# Autodesk Inventor assembly: Samenstelling_backup
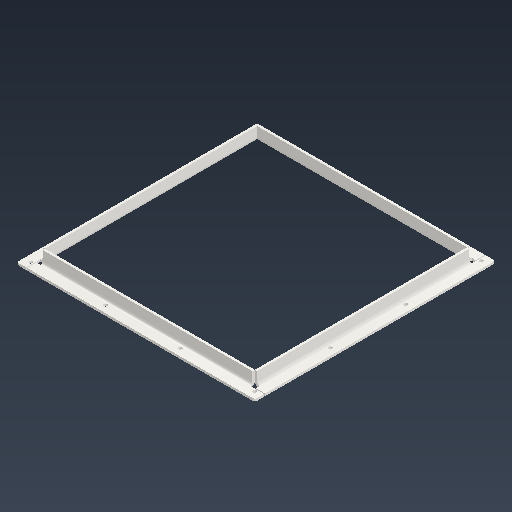
[picture p0: Inventor's stored thumbnail of the model, 512x512]
Saved by Autodesk Inventor 2025.5 (Build 295498000, 498)
## iProperties
RuleStatus: InUse
Created: 2026-10-08
Part Number: Samenstelling_backup
Material: Steel
Document SubType Name: Assembly
Designer: Jasper Kusters
Mass: 3773.45 g
Surface Area: 2154.34 cm^2
Volume: 480.695 cm^3
Density: 7.85 g/cm^3
Titel: =<Titel Isah>
Author: Jasper Kusters
## Documents named in this file (3)
- C:\Vault Workspace\Inventor\CONCEPT\Flenzen\4losse\Samenstelling_backup.iam
- C:\Vault Workspace\Inventor\CONCEPT\Flenzen\HoekInX_450_30_30_8.ipt
- C:\Vault Workspace\Inventor\CONCEPT\Flenzen\HoekInY_455_30_30_8.ipt
## Components (4 placed, 4 different names)
1. HoekInX — Mate:4, Mate:5, Flush:1
2. HoekInY — Mate:9, Flush:2, Flush:3
3. HoekInX_450_30_30_8:2
4. HoekInY_455_30_30_8:2
## Component patterns: (2 elements, first: HoekInX + HoekInY)
## Relationships (6: Mate 3, Flush 3)
- Mate:4: HoekInX
- Mate:5: HoekInX
- Flush:1 (227.5 mm): HoekInX
- Mate:9: HoekInY
- Flush:2: HoekInY
- Flush:3 (225 mm): HoekInY
## Named parameters: InputLengte = 455 mm, InputBreedte = 450 mm, InputFlensHoogte = 30 mm, InputFlensBreedte = 30 mm, InputGatAfstandLengte = 80 mm, InputAantalGatenLengte = 8, InputGatDia = 8 mm, InputAantalGatenBreedte = 8, InputGatAfstandBreedte = 60 mm, InputBestandsnaam = 1
